# Autodesk Inventor assembly: costilla 8_agujerosGrandes
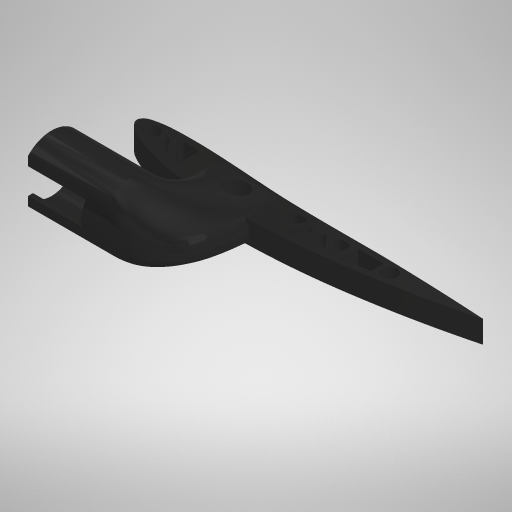
[picture p0: Inventor's stored thumbnail of the model, 512x512]
Saved by Autodesk Inventor 2023 (Build 270158000, 158)
## iProperties
Created: 2023-05-24
Part Number: costilla 8_agujerosGrandes
Document SubType Name: Assembly
Designer: AdminForWorker
Title: costilla 8 v6
Author: AdminForWorker
## Documents named in this file (2)
- C:\Users\brand\Documents\Documentos\ESTUDIOS_DE_GRADO\AEROESPACIAL\TERCERO\SEGUNDO SEMESTRE\TECNOLOGIA\PROYECTO\PIEZAS3D\JUANMA\costilla 8_agujerosGrandes.iam
- C:\Users\brand\Documents\Documentos\ESTUDIOS_DE_GRADO\AEROESPACIAL\TERCERO\SEGUNDO SEMESTRE\TECNOLOGIA\PROYECTO\PIEZAS3D\JUANMA\Component2.ipt
## Components (1 placed, 1 different names)
1. Component2:1 — Nivelación:1
## Relationships (1: Flush 1)
- Nivelación:1 [Flush]: Component2:1
